# Autodesk Inventor assembly: disc 1
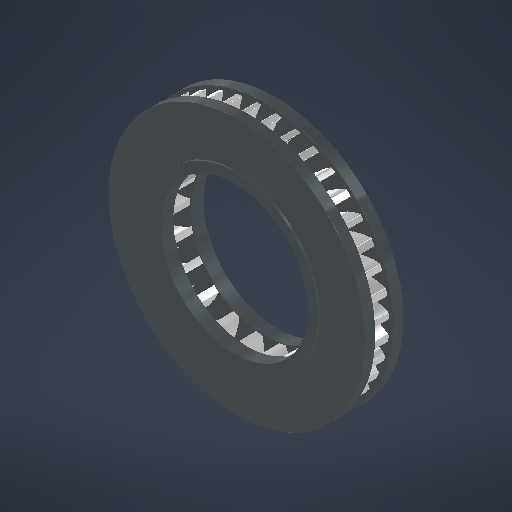
[picture p0: Inventor's stored thumbnail of the model, 512x512]
Saved by Autodesk Inventor 2027 (Build 310192060, 192F)
## iProperties
Created: 2026-07-10
Part Number: disc 1
Document SubType Name: Assembly
Designer: ElieH
Author: ElieH
## Documents named in this file (3)
- C:\Users\ElieH\Desktop\New folder (3)\disc 1.iam
- C:\Users\ElieH\Desktop\disks\disk 1 face.ipt
- C:\Users\ElieH\Desktop\New folder (3)\cooling fins.ipt
## Components (3 placed, 2 different names)
1. disk 1 face:1 — Mate:1
2. disk 1 face:2 — Mate:2, Mate:3
3. cooling fins:1 — Mate:1, Mate:2, Mate:3
## Relationships (3: Mate 3)
- Mate:1: disk 1 face:1 ↔ cooling fins:1
- Mate:2: disk 1 face:2 ↔ cooling fins:1
- Mate:3: disk 1 face:2 ↔ cooling fins:1
